# Autodesk Inventor assembly: PneumaticGripper_v1.1O
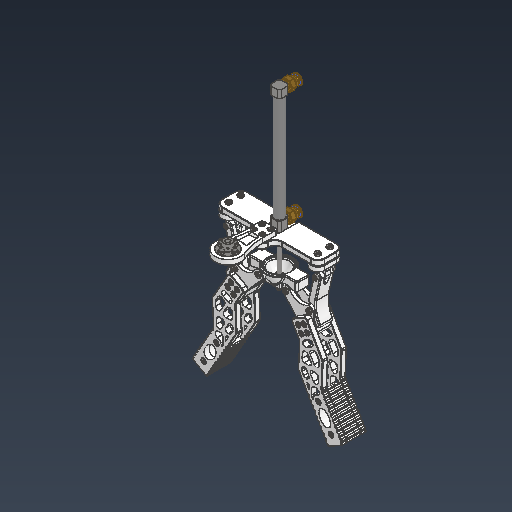
[picture p0: Inventor's stored thumbnail of the model, 512x512]
Saved by Autodesk Inventor 2026.2 (Build 302298010, 298A)
## iProperties
Created: 2026-05-08
Part Number: PneumaticGripper_v1.1O
Document SubType Name: Assembly
Designer: work
Author: work
## Documents named in this file (16)
- C:\Users\khw\Desktop\ARD_v1\ARD_hardware\PneumaticGripper_v1\PneumaticGripper_v1.1O.iam
- C:\Users\khw\Desktop\ARD_v1\ARD_hardware\PneumaticGripper_v1\Pneumatic fitting\CDJ2B10_100\CDJ2B10.iam
- C:\Users\khw\Desktop\ARD_v1\ARD_hardware\PneumaticGripper_v1\Cylinder fixing parts.ipt
- C:\Users\khw\Desktop\ARD_v1\ARD_hardware\PneumaticGripper_v1\Pneumatic fitting\CDJ2B10_100\Rod.ipt
- C:\Users\khw\Desktop\ARD_v1\ARD_hardware\PneumaticGripper_v1\Pneumatic fitting\CDJ2B10_100\AS 1474 - M4(1).ipt
- C:\Users\khw\Desktop\ARD_v1\ARD_hardware\PneumaticGripper_v1\Bottom Link Parts.ipt
- C:\Users\khw\Desktop\ARD_v1\ARD_hardware\PneumaticGripper_v1\Link Support Parts.ipt
- C:\Users\khw\Desktop\ARD_v1\ARD_hardware\PneumaticGripper_v1\Link Parts.ipt
- C:\Users\khw\Desktop\ARD_v1\ARD_hardware\SCARA_v1\Object\KS B 1003 - M 3 x 12.ipt
- C:\Users\khw\Desktop\ARD_v1\ARD_hardware\PneumaticGripper_v1\Object\JIS B 1181 - A_B M3.ipt
- C:\Users\khw\Desktop\ARD_v1\ARD_hardware\PneumaticGripper_v1\Flange Bracket.ipt
- C:\Users\khw\Desktop\ARD_v1\ARD_hardware\PneumaticGripper_v1\Object\flange joint 16pi (5 to 3).ipt
- C:\Users\khw\Desktop\ARD_v1\ARD_hardware\PneumaticGripper_v1\rod-fixing parts.ipt
- C:\Users\khw\Desktop\ARD_v1\ARD_hardware\PneumaticGripper_v1\TONGS SE\O-RING_R.ipt
- C:\Users\khw\Desktop\ARD_v1\ARD_hardware\PneumaticGripper_v1\TONGS SE\O-RING_L.ipt
- C:\Users\khw\Desktop\ARD_v1\ARD_hardware\PneumaticGripper_v1\Object\KS B 1003 - M 3 x 12.ipt
## Components (78 placed, 14 different names)
1. CDJ2B10:1 [sub-assembly] — 메이트:1, 각도:1, 메이트:2, 메이트:8
2. Cylinder fixing parts:1 — 메이트:1, 각도:1, 메이트:2, 메이트:9, 메이트:15, 메이트:16, 메이트:17, 메이트:18, 메이트:19, 메이트:20, 삽입:37, 삽입:38, 삽입:40, 삽입:41, 메이트:42, 메이트:43, 메이트:44, 플러쉬:2, 메이트:45, 메이트:46, 삽입:58, 삽입:59, 삽입:60, 삽입:61
3. Rod:1 — 메이트:4, 메이트:5, 플러쉬:1, 메이트:8, 메이트:9, 메이트:60
4. Flange Bracket:1 — 메이트:39, 메이트:40, 메이트:41, 메이트:42, 메이트:43, 메이트:44, 삽입:49, 삽입:50, 삽입:51, 삽입:52, 삽입:53, 삽입:54, 삽입:55, 삽입:56
5. AS 1474 - M4(1):1 — 메이트:5, 플러쉬:1, 메이트:61
6. AS 1474 - M4(1):2 — 메이트:4, 메이트:67
7. Bottom Link Parts:1 — 삽입:33, 삽입:34, 각도:7, 플러쉬:3, 메이트:55, 메이트:56, 메이트:57, 플러쉬:5, 플러쉬:6, 메이트:63, 메이트:64, 삽입:92, 삽입:97, 접선:1
8. Bottom Link Parts:2 — 메이트:22, 삽입:31, 삽입:48, 각도:7, 메이트:62, 플러쉬:6, 메이트:65, 메이트:66, 삽입:93, 삽입:94
9. Link Support Parts:1 — 메이트:15, 메이트:16, 메이트:17, 메이트:21, 삽입:19, 삽입:20
10. Link Support Parts:2 — 메이트:18, 메이트:19, 메이트:20, 삽입:17, 삽입:18, 메이트:58, 플러쉬:4
11. Link Parts:1 — 메이트:21, 메이트:22, 플러쉬:8, 삽입:90, 삽입:95
12. JIS B 1181 - A_B M3:18 — 삽입:58
13. JIS B 1181 - A_B M3:19 — 삽입:59
14. JIS B 1181 - A_B M3:20 — 삽입:60
15. JIS B 1181 - A_B M3:21 — 삽입:61
16. JIS B 1181 - A_B M3:22 — 삽입:62
17. JIS B 1181 - A_B M3:23 — 삽입:63
18. JIS B 1181 - A_B M3:24 — 삽입:64
19. JIS B 1181 - A_B M3:25 — 삽입:65
20. rod-fixing parts:1 — 플러쉬:3, 메이트:60, 메이트:61, 메이트:62, 메이트:63, 메이트:67
21. O-RING_R:1 — 메이트:47, 메이트:48, 메이트:49, 삽입:66, 삽입:67, 삽입:86, 삽입:87, 삽입:88, 삽입:89
22. O-RING_L:1 — 메이트:47, 메이트:48, 메이트:49, 삽입:68, 삽입:69, 메이트:65, 메이트:66, 플러쉬:7, 삽입:74, 삽입:75, 삽입:76, 삽입:77
23. KS B 1003 - M 3 x 12:30 — 삽입:66
24. KS B 1003 - M 3 x 12:31 — 삽입:67
25. KS B 1003 - M 3 x 12:32 — 삽입:68
26. KS B 1003 - M 3 x 12:33 — 삽입:69
27. O-RING_R:2 — 메이트:55, 메이트:56, 메이트:57, 플러쉬:7, 삽입:78, 삽입:79, 삽입:80, 삽입:81
28. O-RING_L:2 — 삽입:82, 삽입:83, 삽입:84, 삽입:85
29. KS B 1003 - M 3 x 12:34
30. KS B 1003 - M 3 x 12:35
31. KS B 1003 - M 3 x 12:36
32. KS B 1003 - M 3 x 12:37
33. Link Parts:2 — 메이트:58, 플러쉬:4, 플러쉬:5, 메이트:64, 플러쉬:8, 삽입:91, 삽입:96, 접선:1
34. KS B 1003 - M 3 x 12:38 — 삽입:74
35. KS B 1003 - M 3 x 12:39 — 삽입:75
36. KS B 1003 - M 3 x 12:40 — 삽입:76
37. KS B 1003 - M 3 x 12:41 — 삽입:77
38. KS B 1003 - M 3 x 12:42 — 삽입:78
39. KS B 1003 - M 3 x 12:43 — 삽입:79
40. KS B 1003 - M 3 x 12:44 — 삽입:80
41. KS B 1003 - M 3 x 12:45 — 삽입:81
42. KS B 1003 - M 3 x 12:46 — 삽입:82
43. KS B 1003 - M 3 x 12:47 — 삽입:83
44. KS B 1003 - M 3 x 12:48 — 삽입:84
45. KS B 1003 - M 3 x 12:49 — 삽입:85
46. KS B 1003 - M 3 x 12:50 — 삽입:86
47. KS B 1003 - M 3 x 12:51 — 삽입:87
48. KS B 1003 - M 3 x 12:52 — 삽입:88
49. KS B 1003 - M 3 x 12:53 — 삽입:89
50. KS B 1003 - M 3 x 12:54 — 삽입:90
51. KS B 1003 - M 3 x 12:55 — 삽입:91
52. KS B 1003 - M 3 x 12:56 — 삽입:92
53. KS B 1003 - M 3 x 12:57 — 삽입:93
54. KS B 1003 - M 3 x 12:58 — 삽입:94
55. KS B 1003 - M 3 x 12:59 — 삽입:95
56. KS B 1003 - M 3 x 12:60 — 삽입:96
57. KS B 1003 - M 3 x 12:61 — 삽입:97
58. KS B 1003 - M 3 x 12:22 — 삽입:49
59. KS B 1003 - M 3 x 12:23 — 삽입:50
60. KS B 1003 - M 3 x 12:24 — 삽입:51
61. KS B 1003 - M 3 x 12:25 — 삽입:52
62. KS B 1003 - M 3 x 12:26 — 삽입:53
63. KS B 1003 - M 3 x 12:27 — 삽입:54
64. KS B 1003 - M 3 x 12:28 — 삽입:55
65. KS B 1003 - M 3 x 12:29 — 삽입:56
66. KS B 1003 - M 3 x 12:18 — 삽입:17
67. KS B 1003 - M 3 x 12:19 — 삽입:18
68. KS B 1003 - M 3 x 12:20 — 삽입:19
69. KS B 1003 - M 3 x 12:21 — 삽입:20
70. flange joint 16pi (5 to 3):1 — 메이트:39, 메이트:40, 메이트:41, 삽입:62, 삽입:63, 삽입:64, 삽입:65
71. JIS B 1181 - A_B M3:1 — 삽입:31
72. JIS B 1181 - A_B M3:2 — 삽입:33
73. JIS B 1181 - A_B M3:3 — 삽입:34
74. JIS B 1181 - A_B M3:6 — 삽입:37
75. JIS B 1181 - A_B M3:7 — 삽입:38
76. JIS B 1181 - A_B M3:9 — 삽입:40
77. JIS B 1181 - A_B M3:10 — 삽입:41
78. JIS B 1181 - A_B M3:17 — 삽입:48
## Relationships (111: Insert 60, Mate 40, Flush 8, Angle 2, Tangent 1)
- 메이트:1 [Mate]: CDJ2B10:1 ↔ Cylinder fixing parts:1
- 각도:1 [Angle] (0 deg): CDJ2B10:1 ↔ Cylinder fixing parts:1
- 메이트:2 [Mate]: CDJ2B10:1 ↔ Cylinder fixing parts:1
- 메이트:4 [Mate]: Rod:1 ↔ AS 1474 - M4(1):2
- 메이트:5 [Mate]: Rod:1 ↔ AS 1474 - M4(1):1
- 플러쉬:1 [Flush] (5 mm): Rod:1 ↔ AS 1474 - M4(1):1
- 메이트:8 [Mate]: CDJ2B10:1 ↔ Rod:1
- 메이트:9 [Mate]: Cylinder fixing parts:1 ↔ Rod:1
- 메이트:15 [Mate]: Cylinder fixing parts:1 ↔ Link Support Parts:1
- 메이트:16 [Mate]: Cylinder fixing parts:1 ↔ Link Support Parts:1
- 메이트:17 [Mate]: Cylinder fixing parts:1 ↔ Link Support Parts:1
- 메이트:18 [Mate]: Cylinder fixing parts:1 ↔ Link Support Parts:2
- 메이트:19 [Mate]: Cylinder fixing parts:1 ↔ Link Support Parts:2
- 메이트:20 [Mate]: Cylinder fixing parts:1 ↔ Link Support Parts:2
- 메이트:21 [Mate]: Link Support Parts:1 ↔ Link Parts:1
- 메이트:22 [Mate]: Bottom Link Parts:2 ↔ Link Parts:1
- 삽입:17 [Insert]: Link Support Parts:2 ↔ KS B 1003 - M 3 x 12:18
- 삽입:18 [Insert]: Link Support Parts:2 ↔ KS B 1003 - M 3 x 12:19
- 삽입:19 [Insert]: Link Support Parts:1 ↔ KS B 1003 - M 3 x 12:20
- 삽입:20 [Insert]: Link Support Parts:1 ↔ KS B 1003 - M 3 x 12:21
- 삽입:31 [Insert]: Bottom Link Parts:2 ↔ JIS B 1181 - A_B M3:1
- 삽입:33 [Insert]: Bottom Link Parts:1 ↔ JIS B 1181 - A_B M3:2
- 삽입:34 [Insert]: Bottom Link Parts:1 ↔ JIS B 1181 - A_B M3:3
- 삽입:37 [Insert]: Cylinder fixing parts:1 ↔ JIS B 1181 - A_B M3:6
- 삽입:38 [Insert]: Cylinder fixing parts:1 ↔ JIS B 1181 - A_B M3:7
- 삽입:40 [Insert]: Cylinder fixing parts:1 ↔ JIS B 1181 - A_B M3:9
- 삽입:41 [Insert]: Cylinder fixing parts:1 ↔ JIS B 1181 - A_B M3:10
- 삽입:48 [Insert]: Bottom Link Parts:2 ↔ JIS B 1181 - A_B M3:17
- 메이트:39 [Mate]: Flange Bracket:1 ↔ flange joint 16pi (5 to 3):1
- 메이트:40 [Mate]: Flange Bracket:1 ↔ flange joint 16pi (5 to 3):1
- 메이트:41 [Mate]: Flange Bracket:1 ↔ flange joint 16pi (5 to 3):1
- 메이트:42 [Mate]: Cylinder fixing parts:1 ↔ Flange Bracket:1
- 메이트:43 [Mate]: Cylinder fixing parts:1 ↔ Flange Bracket:1
- 메이트:44 [Mate]: Cylinder fixing parts:1 ↔ Flange Bracket:1
- 삽입:49 [Insert]: Flange Bracket:1 ↔ KS B 1003 - M 3 x 12:22
- 삽입:50 [Insert]: Flange Bracket:1 ↔ KS B 1003 - M 3 x 12:23
- 삽입:51 [Insert]: Flange Bracket:1 ↔ KS B 1003 - M 3 x 12:24
- 삽입:52 [Insert]: Flange Bracket:1 ↔ KS B 1003 - M 3 x 12:25
- 삽입:53 [Insert]: Flange Bracket:1 ↔ KS B 1003 - M 3 x 12:26
- 삽입:54 [Insert]: Flange Bracket:1 ↔ KS B 1003 - M 3 x 12:27
- 삽입:55 [Insert]: Flange Bracket:1 ↔ KS B 1003 - M 3 x 12:28
- 삽입:56 [Insert]: Flange Bracket:1 ↔ KS B 1003 - M 3 x 12:29
- 플러쉬:2 [Flush] (-150 mm): Cylinder fixing parts:1
- 메이트:45 [Mate]: Cylinder fixing parts:1
- 메이트:46 [Mate]: Cylinder fixing parts:1
- 삽입:58 [Insert]: Cylinder fixing parts:1 ↔ JIS B 1181 - A_B M3:18
- 삽입:59 [Insert]: Cylinder fixing parts:1 ↔ JIS B 1181 - A_B M3:19
- 삽입:60 [Insert]: Cylinder fixing parts:1 ↔ JIS B 1181 - A_B M3:20
- 삽입:61 [Insert]: Cylinder fixing parts:1 ↔ JIS B 1181 - A_B M3:21
- 삽입:62 [Insert]: JIS B 1181 - A_B M3:22 ↔ flange joint 16pi (5 to 3):1
- 삽입:63 [Insert]: JIS B 1181 - A_B M3:23 ↔ flange joint 16pi (5 to 3):1
- 삽입:64 [Insert]: JIS B 1181 - A_B M3:24 ↔ flange joint 16pi (5 to 3):1
- 삽입:65 [Insert]: JIS B 1181 - A_B M3:25 ↔ flange joint 16pi (5 to 3):1
- 각도:7 [Angle] (0 deg): Bottom Link Parts:1 ↔ Bottom Link Parts:2
- 메이트:47 [Mate]: O-RING_R:1 ↔ O-RING_L:1
- 메이트:48 [Mate]: O-RING_R:1 ↔ O-RING_L:1
- 메이트:49 [Mate]: O-RING_R:1 ↔ O-RING_L:1
- 삽입:66 [Insert]: O-RING_R:1 ↔ KS B 1003 - M 3 x 12:30
- 삽입:67 [Insert]: O-RING_R:1 ↔ KS B 1003 - M 3 x 12:31
- 삽입:68 [Insert]: O-RING_L:1 ↔ KS B 1003 - M 3 x 12:32
- 삽입:69 [Insert]: O-RING_L:1 ↔ KS B 1003 - M 3 x 12:33
- 플러쉬:3 [Flush]: Bottom Link Parts:1 ↔ rod-fixing parts:1
- [Mate]: O-RING_R:2 ↔ O-RING_L:2
- [Mate]: O-RING_R:2 ↔ O-RING_L:2
- [Mate]: O-RING_R:2 ↔ O-RING_L:2
- [Insert]: O-RING_R:2 ↔ KS B 1003 - M 3 x 12:34
- [Insert]: O-RING_R:2 ↔ KS B 1003 - M 3 x 12:35
- [Insert]: O-RING_L:2 ↔ KS B 1003 - M 3 x 12:36
- [Insert]: O-RING_L:2 ↔ KS B 1003 - M 3 x 12:37
- 메이트:55 [Mate]: Bottom Link Parts:1 ↔ O-RING_R:2
- 메이트:56 [Mate]: Bottom Link Parts:1 ↔ O-RING_R:2
- 메이트:57 [Mate]: Bottom Link Parts:1 ↔ O-RING_R:2
- 메이트:58 [Mate]: Link Support Parts:2 ↔ Link Parts:2
- 플러쉬:4 [Flush]: Link Support Parts:2 ↔ Link Parts:2
- 플러쉬:5 [Flush]: Bottom Link Parts:1 ↔ Link Parts:2
- 메이트:60 [Mate]: Rod:1 ↔ rod-fixing parts:1
- 메이트:61 [Mate]: AS 1474 - M4(1):1 ↔ rod-fixing parts:1
- 메이트:62 [Mate]: Bottom Link Parts:2 ↔ rod-fixing parts:1
- 플러쉬:6 [Flush]: Bottom Link Parts:1 ↔ Bottom Link Parts:2
- 메이트:63 [Mate]: Bottom Link Parts:1 ↔ rod-fixing parts:1
- 메이트:64 [Mate]: Bottom Link Parts:1 ↔ Link Parts:2
- 메이트:65 [Mate]: Bottom Link Parts:2 ↔ O-RING_L:1
- 메이트:66 [Mate]: Bottom Link Parts:2 ↔ O-RING_L:1
- 플러쉬:7 [Flush]: O-RING_L:1 ↔ O-RING_R:2
- 플러쉬:8 [Flush]: Link Parts:1 ↔ Link Parts:2
- 메이트:67 [Mate]: AS 1474 - M4(1):2 ↔ rod-fixing parts:1
- 삽입:74 [Insert]: O-RING_L:1 ↔ KS B 1003 - M 3 x 12:38
- 삽입:75 [Insert]: O-RING_L:1 ↔ KS B 1003 - M 3 x 12:39
- 삽입:76 [Insert]: O-RING_L:1 ↔ KS B 1003 - M 3 x 12:40
- 삽입:77 [Insert]: O-RING_L:1 ↔ KS B 1003 - M 3 x 12:41
- 삽입:78 [Insert]: O-RING_R:2 ↔ KS B 1003 - M 3 x 12:42
- 삽입:79 [Insert]: O-RING_R:2 ↔ KS B 1003 - M 3 x 12:43
- 삽입:80 [Insert]: O-RING_R:2 ↔ KS B 1003 - M 3 x 12:44
- 삽입:81 [Insert]: O-RING_R:2 ↔ KS B 1003 - M 3 x 12:45
- 삽입:82 [Insert]: O-RING_L:2 ↔ KS B 1003 - M 3 x 12:46
- 삽입:83 [Insert]: O-RING_L:2 ↔ KS B 1003 - M 3 x 12:47
- 삽입:84 [Insert]: O-RING_L:2 ↔ KS B 1003 - M 3 x 12:48
- 삽입:85 [Insert]: O-RING_L:2 ↔ KS B 1003 - M 3 x 12:49
- 삽입:86 [Insert]: O-RING_R:1 ↔ KS B 1003 - M 3 x 12:50
- 삽입:87 [Insert]: O-RING_R:1 ↔ KS B 1003 - M 3 x 12:51
- 삽입:88 [Insert]: O-RING_R:1 ↔ KS B 1003 - M 3 x 12:52
- 삽입:89 [Insert]: O-RING_R:1 ↔ KS B 1003 - M 3 x 12:53
- 삽입:90 [Insert]: Link Parts:1 ↔ KS B 1003 - M 3 x 12:54
- 삽입:91 [Insert]: Link Parts:2 ↔ KS B 1003 - M 3 x 12:55
- 삽입:92 [Insert]: Bottom Link Parts:1 ↔ KS B 1003 - M 3 x 12:56
- 삽입:93 [Insert]: Bottom Link Parts:2 ↔ KS B 1003 - M 3 x 12:57
- 삽입:94 [Insert]: Bottom Link Parts:2 ↔ KS B 1003 - M 3 x 12:58
- 삽입:95 [Insert]: Link Parts:1 ↔ KS B 1003 - M 3 x 12:59
- 삽입:96 [Insert]: Link Parts:2 ↔ KS B 1003 - M 3 x 12:60
- 삽입:97 [Insert]: Bottom Link Parts:1 ↔ KS B 1003 - M 3 x 12:61
- 접선:1 [Tangent]: Bottom Link Parts:1 ↔ Link Parts:2
## Named parameters: d142_d132 = 0 mm, d143_d133 = 0 mm, d144_d134 = 0 mm, d145_d135 = 0 mm, d146_d136 = 0 mm, d147_d137 = 0 mm, d148_d138 = 0 mm
